# Autodesk Inventor assembly: SE0004AN001_G01_805
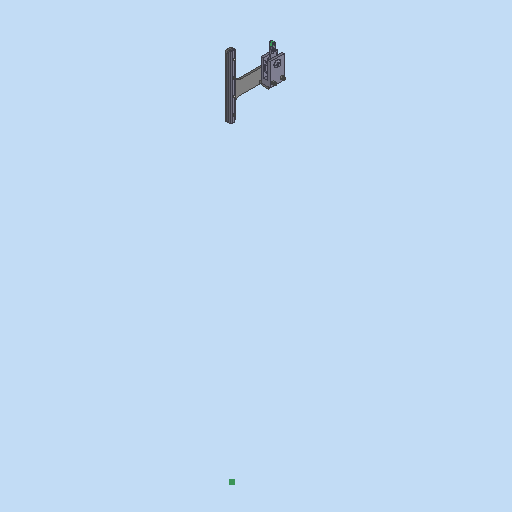
[picture p0: Inventor's stored thumbnail of the model, 512x512]
Saved by Autodesk Inventor 2023.3 (Build 273359000, 359)
## iProperties
RuleStatus: InUse
Created: 2021-06-29
Part Number: SE0004AN001_G01_805
Description: =<RBPARTNOTITLE2>
Document SubType Name: Assembly
Designer: frt9bw
Mass: 858.616 g
Surface Area: 612.424 cm^2
Volume: 115.967 cm^3
Density: 7.40396 g/cm^3
AnP_Material: =<Material>
AnP_TemplVers: 20200821
RBDOCUMENTTYPE: DRF
RBDOCUMENTVERSION: 00
RBDRAWINGMAINSCALE: 1:1
RBDRAWINGMISSINGSPEC: --
RBDRAWINGVOLUME: --
RBDSV1: 0850
RBGBEDGESIN1: +0,5
RBGBEDGESIN2: +0,2
RBGBEDGESOUT1: -0,3
RBGBEDGESOUT2: -0,1
RBMATERIAL: =<Material>
RBMATMEETS: --
RBMATNO: =<Part Number>
RBPARTMADEOF: --
RBPARTNO: SIEHE MNR
RBPARTNOTITLE1: --
RBPARTSAFETYINDICATOR: --
RBSURFACE: --
RBSURFACE2: --
RBZEDGESNORM: ISO13715:2002-06
RBZGENDIMCLASS: m
RBZGENDIMNORM: ISO 2768-1:1989-11
RBZGENGEOCLASS: H
RBZGENGEONORM: ISO 2768-2:1989-11
RBZSURFACENORM: ISO13D2:2002-02
RBZTOLERANCENORM: ISO 14405-1:2010-12
Author: frt9bw
Keywords: =<RBPARTMADEOF>
Comments: =<RBSURFACE2>
Revision Number: 01
## Documents named in this file (8)
- C:\Users\rea9an\Documents\Inventor\TCAI2412_te1910_EM\AS00000983.iam
- C:\Users\rea9an\Documents\Inventor\TCAI2412_te1910_EM\PT00004463.ipt
- C:\Users\rea9an\Documents\Inventor\TCAI2412_te1910_EM\PT00004479.ipt
- C:\Users\rea9an\Documents\Inventor\TCAI2412_te1910_EM\PT00004834.ipt
- C:\Users\rea9an\Documents\Inventor\TCAI2412_te1910_EM\PT00004823.ipt
- C:\Users\rea9an\Documents\Inventor\TCAI2412_te1910_EM\PT00004473.ipt
- C:\Users\rea9an\Documents\Inventor\TCAI2412_te1910_EM\PT00004408.ipt
- C:\Users\rea9an\Documents\Inventor\TCAI2412_te1910_EM\PT00004458.ipt
## Components (12 placed, 7 different names)
1. PT00004463:1 — Einfügen:9, Passend:1, Einfügen:10, Einfügen:11
2. PT00004479:1 — Einfügen:12, Einfügen:13, Einfügen:20, Einfügen:21
3. PT00004834:1 — Einfügen:19
4. PT00004834:2 — Einfügen:18
5. PT00004823:1 — Einfügen:21
6. PT00004823:2 — Einfügen:20
7. PT00004473:1 — Einfügen:9, Passend:1
8. PT00004408:1 — Einfügen:16
9. PT00004408:2 — Einfügen:15
10. PT00004408:3 — Einfügen:14
11. PT00004408:4 — Einfügen:17
12. PT00004458:1 — Einfügen:10, Einfügen:11, Einfügen:12, Einfügen:13, Einfügen:14, Einfügen:15, Einfügen:16, Einfügen:17, Einfügen:18, Einfügen:19
## Relationships (14: Insert 13, Mate 1)
- Einfügen:9 [Insert]: PT00004463:1 ↔ PT00004473:1
- Passend:1 [Mate]: PT00004463:1 ↔ PT00004473:1
- Einfügen:10 [Insert]: PT00004463:1 ↔ PT00004458:1
- Einfügen:11 [Insert]: PT00004463:1 ↔ PT00004458:1
- Einfügen:12 [Insert]: PT00004479:1 ↔ PT00004458:1
- Einfügen:13 [Insert]: PT00004479:1 ↔ PT00004458:1
- Einfügen:14 [Insert]: PT00004408:3 ↔ PT00004458:1
- Einfügen:15 [Insert]: PT00004408:2 ↔ PT00004458:1
- Einfügen:16 [Insert]: PT00004408:1 ↔ PT00004458:1
- Einfügen:17 [Insert]: PT00004408:4 ↔ PT00004458:1
- Einfügen:18 [Insert]: PT00004834:2 ↔ PT00004458:1
- Einfügen:19 [Insert]: PT00004834:1 ↔ PT00004458:1
- Einfügen:20 [Insert]: PT00004479:1 ↔ PT00004823:2
- Einfügen:21 [Insert]: PT00004479:1 ↔ PT00004823:1
